# Autodesk Inventor assembly: Assembly9
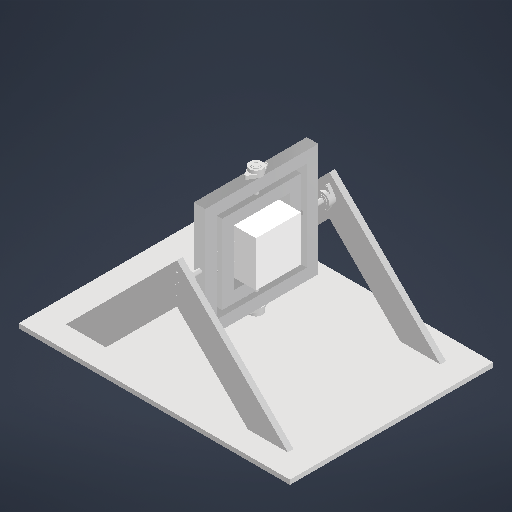
[picture p0: Inventor's stored thumbnail of the model, 512x512]
Saved by Autodesk Inventor 2026.1 (Build 301233000, 233)
## iProperties
Created: 2025-11-11
Part Number: Assembly9
Document SubType Name: Assembly
Designer: shiva
Author: shiva
## Documents named in this file (5)
- D:\assignments\SEM 1\CAM\RPM\bigger version\Assembly9.iam
- D:\assignments\SEM 1\CAM\RPM\bigger version\base assembly\base subassembly.iam
- D:\assignments\SEM 1\CAM\RPM\bigger version\outer sub assembly\outer frame.iam
- D:\assignments\SEM 1\CAM\RPM\bigger version\inner sub assembly\inner subassembly.iam
- D:\assignments\SEM 1\CAM\RPM\bigger version\payload sub assembly\payload sub assembly.iam
## Components (4 placed, 4 different names)
1. base subassembly:1 [sub-assembly] — Mate:1, Flush:1
2. outer frame:1 [sub-assembly] — Mate:1, Mate:2, Flush:1, Flush:2
3. inner subassembly:1 [sub-assembly] — Mate:2, Mate:3, Mate:4, Flush:2, Flush:3
4. payload sub assembly:1 [sub-assembly] — Mate:3, Mate:4, Flush:3
## Relationships (7: Mate 4, Flush 3)
- Mate:1: base subassembly:1 ↔ outer frame:1
- Mate:2: outer frame:1 ↔ inner subassembly:1
- Mate:3: inner subassembly:1 ↔ payload sub assembly:1
- Mate:4: inner subassembly:1 ↔ payload sub assembly:1
- Flush:1: base subassembly:1 ↔ outer frame:1
- Flush:2: outer frame:1 ↔ inner subassembly:1
- Flush:3: inner subassembly:1 ↔ payload sub assembly:1
